# Autodesk Inventor assembly: EG_Tup
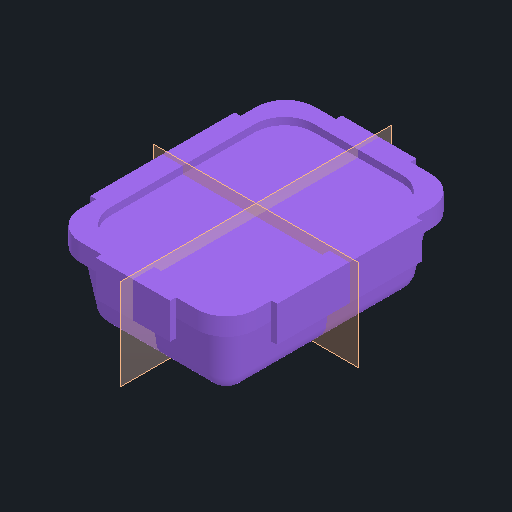
[picture p0: Inventor's stored thumbnail of the model, 512x512]
Saved by Autodesk Inventor 2026.1 (Build 301233020, 233B)
## iProperties
Created: 2026-06-04
Part Number: EG_Tup
Document SubType Name: Assembly
Designer: matpo
Author: matpo
## Documents named in this file (3)
- C:\Users\matpo\OneDrive - HESSO\2Annee\Projet_Thématique_PB0326\2_Partie_Mecanique\EG_Tup.iam
- C:\Users\matpo\OneDrive - HESSO\2Annee\Projet_Thématique_PB0326\2_Partie_Mecanique\TUPPERWARE.ipt
- C:\Users\matpo\OneDrive - HESSO\2Annee\Projet_Thématique_PB0326\2_Partie_Mecanique\EG_Boite.iam
## Components (2 placed, 2 different names)
1. TUPPERWARE:1 — Placage:1, Placage:2, Placage:3
2. EG_Boite:1 [sub-assembly] — Placage:1, Placage:2, Placage:3
## Relationships (3: Mate 3)
- Placage:1 [Mate]: TUPPERWARE:1 ↔ EG_Boite:1
- Placage:2 [Mate] (-2.5 mm): TUPPERWARE:1 ↔ EG_Boite:1
- Placage:3 [Mate] (-2.5 mm): TUPPERWARE:1 ↔ EG_Boite:1
